# Autodesk Inventor assembly: Festo_VAS-15
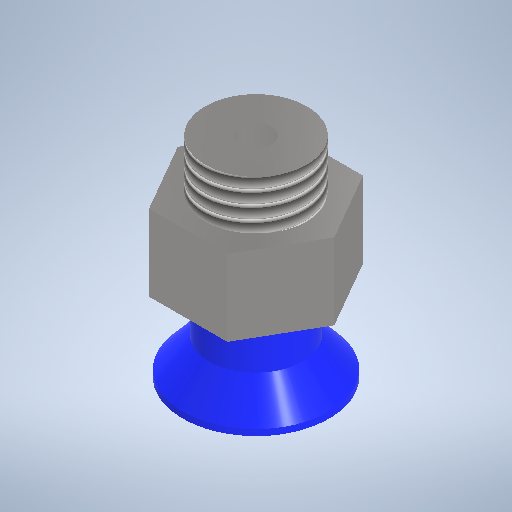
[picture p0: Inventor's stored thumbnail of the model, 512x512]
Saved by Autodesk Inventor 2025.1 (Build 291241000, 241)
## iProperties
Created: 2026-10-22
Part Number: Festo_VAS-15
Document SubType Name: Assembly
Designer: Ваня
Author: Ваня
## Documents named in this file (3)
- C:\Users\Ваня\Desktop\SCARA_ETZ_2027\3D Модели\Для сборки\Захват\Присоска\Festo_VAS-15.iam
- C:\Users\Ваня\Desktop\SCARA_ETZ_2027\3D Модели\Для сборки\Захват\Присоска\Металлическая часть.ipt
- C:\Users\Ваня\Desktop\SCARA_ETZ_2027\3D Модели\Для сборки\Захват\Присоска\Резиновый наконечник.ipt
## Components (2 placed, 2 different names)
1. Металлическая часть:1 — Жесткий:1
2. Резиновый наконечник:1 — Жесткий:1
## Relationships (1: WeldJoint 1)
- Жесткий:1 [WeldJoint]: Металлическая часть:1 ↔ Резиновый наконечник:1
